# Autodesk Inventor assembly: dau_robot
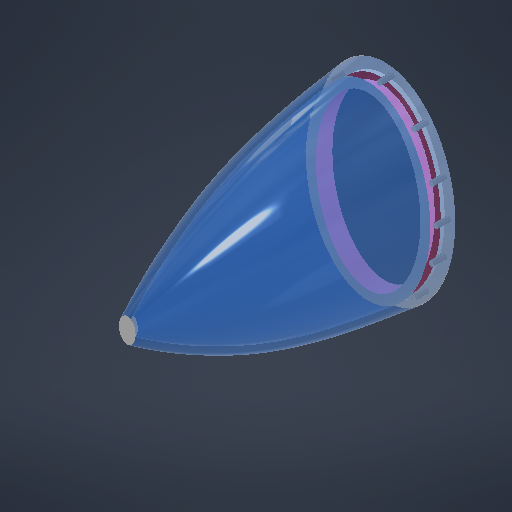
[picture p0: Inventor's stored thumbnail of the model, 512x512]
Saved by Autodesk Inventor 2027 (Build 310192060, 192F)
## iProperties
Created: 2026-08-27
Part Number: dau_robot
Document SubType Name: Assembly
Designer: DELL
Author: DELL
## Documents named in this file (7)
- D:\Year2\đồ án tốt nghịp\đồ án tốt nghiệp v2\mới nhất v14\FULL_FISH\Workgroups\NotInProject\dau_robot.iam
- D:\Year2\đồ án tốt nghịp\đồ án tốt nghiệp v2\mới nhất v14\FULL_FISH\Workgroups\NotInProject\head.ipt
- D:\Year2\đồ án tốt nghịp\đồ án tốt nghiệp v2\mới nhất v14\FULL_FISH\Workgroups\NotInProject\nap_dau_ca.ipt
- D:\Year2\đồ án tốt nghịp\đồ án tốt nghiệp v2\mới nhất v14\FULL_FISH\Workgroups\NotInProject\solid_in_head.ipt
- D:\Year2\đồ án tốt nghịp\đồ án tốt nghiệp v2\mới nhất v14\FULL_FISH\Workgroups\NotInProject\manh_nap_tren.ipt
- D:\Year2\đồ án tốt nghịp\đồ án tốt nghiệp v2\mới nhất v14\FULL_FISH\Workgroups\NotInProject\manh_nap_duoi.ipt
- D:\Year2\đồ án tốt nghịp\đồ án tốt nghiệp v2\mới nhất v14\FULL_FISH\Workgroups\NotInProject\nap_dau_ca1.ipt
## Components (6 placed, 6 different names)
1. head:1
2. nap_dau_ca:1 — Mate:1, Rigid:2, Rigid:3, Mate:2
3. solid_in_head:1 — Mate:1
4. manh_nap_tren:1 — Rigid:2, Angle:1, Rigid:4, Mate:3
5. manh_nap_duoi:1 — Rigid:3, Flush:3
6. nap_dau_ca1:1 — Rigid:4, Mate:3, Flush:3
## Relationships (10: Mate 3, WeldJoint 3, Flush 3, Angle 1)
- Mate:1: nap_dau_ca:1 ↔ solid_in_head:1
- Rigid:2 [WeldJoint]: nap_dau_ca:1 ↔ manh_nap_tren:1
- Rigid:3 [WeldJoint]: nap_dau_ca:1 ↔ manh_nap_duoi:1
- Mate:2: nap_dau_ca:1
- Angle:1 (90 deg): manh_nap_tren:1
- Flush:1 (30 mm)
- Flush:2 (-30 mm)
- Rigid:4 [WeldJoint]: manh_nap_tren:1 ↔ nap_dau_ca1:1
- Mate:3: manh_nap_tren:1 ↔ nap_dau_ca1:1
- Flush:3: manh_nap_duoi:1 ↔ nap_dau_ca1:1
